# Autodesk Inventor assembly: thread-full
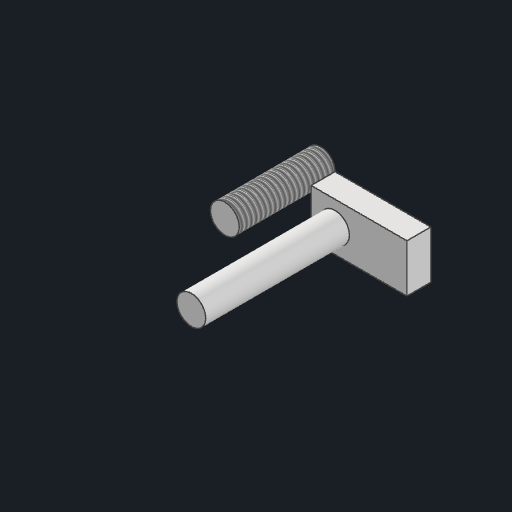
[picture p0: Inventor's stored thumbnail of the model, 512x512]
Saved by Autodesk Inventor 2026.1 (Build 301233000, 233)
## iProperties
Created: 2026-10-30
Part Number: thread-full
Document SubType Name: Assembly
Designer: david
Author: anony
## Documents named in this file (4)
- C:\Users\anony\OneDrive\Desktop\AI Projects\CAD Convert\corpus\generated\asmgrip\thread-full.iam
- C:\Users\anony\OneDrive\Desktop\AI Projects\CAD Convert\corpus\generated\asmparts\box.ipt
- C:\Users\anony\OneDrive\Desktop\AI Projects\CAD Convert\corpus\generated\asmparts\pin.ipt
- C:\Users\anony\OneDrive\Desktop\AI Projects\CAD Convert\corpus\generated\thread\full.ipt
## Components (3 placed, 3 different names)
1. box:1 — Mate:2, Mate:3, Mate:4, Mate:5
2. pin:1 — Mate:1, Insert:1, Insert:2
3. full:1 — Mate:1, Mate:2, Mate:3, Insert:1, Insert:2, Mate:4, Mate:5
## Relationships (7: Mate 5, Insert 2)
- Mate:1: pin:1 ↔ full:1
- Mate:2: box:1 ↔ full:1
- Mate:3: box:1 ↔ full:1
- Insert:1: pin:1 ↔ full:1
- Insert:2: pin:1 ↔ full:1
- Mate:4: box:1 ↔ full:1
- Mate:5: box:1 ↔ full:1
